# Autodesk Inventor assembly: RDS-500-1000 Frame
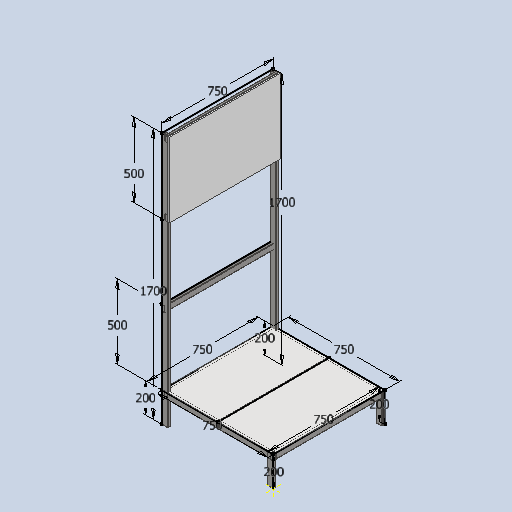
[picture p0: Inventor's stored thumbnail of the model, 512x512]
Saved by Autodesk Inventor 2026.2 (Build 302298000, 298)
## iProperties
_SolveAssemblyDoc: Frame Generator Solve Assembly
_Version: 25.0.0
Created: 2026-10-27
Part Number: RDS-500-1000 Frame
Document SubType Name: Assembly
Designer: user
Author: user
## Documents named in this file (5)
- C:\Users\admin\Documents\Inventor\PRF-Parfino\RDS-500 Reagent Dosing Station\RDS-500-1000 Frame.iam
- C:\Users\admin\Documents\Inventor\PRF-Parfino\RDS-500 Reagent Dosing Station\RDS-500-1001 frame.iam
- C:\Users\admin\Documents\Inventor\PRF-Parfino\RDS-500 Reagent Dosing Station\RDS-500-1000 Frame\Frame\Frame 1793094875818.iam
- C:\Users\admin\Documents\Inventor\PRF-Parfino\RDS-500 Reagent Dosing Station\RDS-500-1002 sheet.ipt
- C:\Users\admin\Documents\Inventor\PRF-Parfino\RDS-500 Reagent Dosing Station\RDS-500-1003 sheet.ipt
## Components (4 placed, 4 different names)
1. RDS-500-1001 frame:1 [sub-assembly]
2. Frame 1793094875818:1 [sub-assembly] — Mate:1, Flush:1, Flush:2, Mate:2, Flush:3, Flush:4
3. RDS-500-1002 sheet:1 — Mate:1, Flush:1, Flush:2
4. RDS-500-1003 sheet:1 — Mate:2, Flush:3, Flush:4
## Relationships (6: Flush 4, Mate 2)
- Mate:1: Frame 1793094875818:1 ↔ RDS-500-1002 sheet:1
- Flush:1: Frame 1793094875818:1 ↔ RDS-500-1002 sheet:1
- Flush:2: Frame 1793094875818:1 ↔ RDS-500-1002 sheet:1
- Mate:2: Frame 1793094875818:1 ↔ RDS-500-1003 sheet:1
- Flush:3: Frame 1793094875818:1 ↔ RDS-500-1003 sheet:1
- Flush:4: Frame 1793094875818:1 ↔ RDS-500-1003 sheet:1
